# Autodesk Inventor assembly: LegL
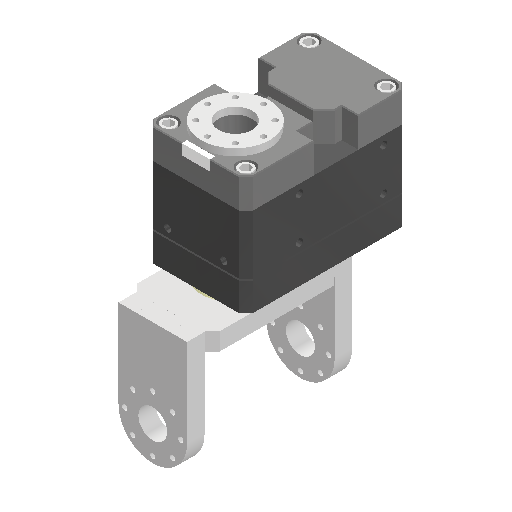
[picture p0: Inventor's stored thumbnail of the model, 512x512]
Saved by Autodesk Inventor 2025.2 (Build 292293000, 293)
## iProperties
Created: 2025-06-22
Part Number: LegL
Document SubType Name: Assembly
Designer: ricoa
Author: ricoa
## Documents named in this file (4)
- C:\Users\ricoa\Desktop\PROYEK AKHIR\project_pororo\Leg\LegL.iam
- C:\Users\ricoa\Desktop\PROYEK AKHIR\project_pororo\Leg\Pelv1.ipt
- C:\Users\ricoa\Desktop\PROYEK AKHIR\project_pororo\Leg\Pelv2.ipt
- C:\Users\ricoa\Desktop\PROYEK AKHIR\project_pororo\XM430-W350-R\XM430-W350-R\XM430-W350-R.iam
## Components (4 placed, 3 different names)
1. Pelv1:1 — Mate:72, Flush:13, Flush:14
2. Pelv1:2 — Flush:11, Mate:71, Flush:12
3. Pelv2:1 — Flush:11, Mate:71, Flush:12, Mate:72, Flush:13, Flush:14, Mate:73, Mate:74, Mate:75
4. XM430-W350-R:1 [sub-assembly] — Mate:73, Mate:74, Mate:75
## Relationships (9: Mate 5, Flush 4)
- Flush:11: Pelv1:2 ↔ Pelv2:1
- Mate:71: Pelv1:2 ↔ Pelv2:1
- Flush:12: Pelv1:2 ↔ Pelv2:1
- Mate:72: Pelv1:1 ↔ Pelv2:1
- Flush:13: Pelv1:1 ↔ Pelv2:1
- Flush:14: Pelv1:1 ↔ Pelv2:1
- Mate:73: Pelv2:1 ↔ XM430-W350-R:1
- Mate:74: Pelv2:1 ↔ XM430-W350-R:1
- Mate:75: Pelv2:1 ↔ XM430-W350-R:1
